# Autodesk Inventor assembly: Gimbal_ze_starym_rodem
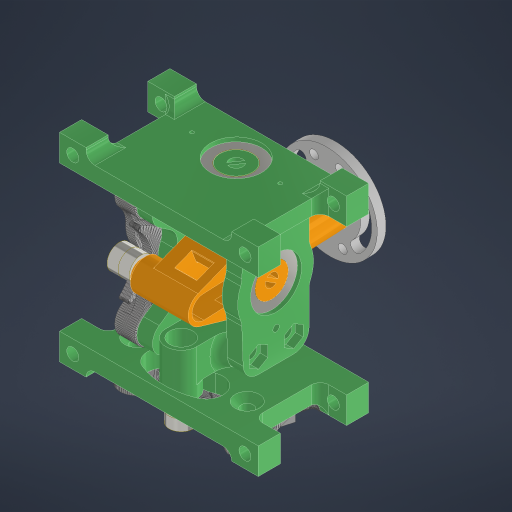
[picture p0: Inventor's stored thumbnail of the model, 512x512]
Saved by Autodesk Inventor 2023 (Build 270158000, 158)
## iProperties
Created: 2026-11-06
Part Number: Gimbal_ze_starym_rodem
Document SubType Name: Assembly
Designer: szykr
Author: szykr
## Documents named in this file (14)
- D:\Folder Instalacyjny\GitHub Pliki\HOTAS\Inventor\Gimbal\Gimbal_ze_starym_rodem.iam
- D:\Folder Instalacyjny\GitHub Pliki\HOTAS\Inventor\Gimbal\gimbal_cam.ipt
- D:\Folder Instalacyjny\GitHub Pliki\HOTAS\Inventor\Gimbal\gimbal_core_bearing_carrier.ipt
- D:\Folder Instalacyjny\GitHub Pliki\HOTAS\Inventor\Gimbal\gimbal_core_bearing_carrier_6802zz.ipt
- D:\Folder Instalacyjny\GitHub Pliki\HOTAS\Inventor\Gimbal\gimbal_core_non_pot_side.ipt
- D:\Folder Instalacyjny\GitHub Pliki\HOTAS\Inventor\Gimbal\gimbal_core_pot_side.ipt
- D:\Folder Instalacyjny\GitHub Pliki\HOTAS\Inventor\Gimbal\gimbal_frame.ipt
- D:\Folder Instalacyjny\GitHub Pliki\HOTAS\Inventor\Gimbal\gimbal_frame_6802zz.ipt
- D:\Folder Instalacyjny\GitHub Pliki\HOTAS\Inventor\Gimbal\gimbal_lever_arm.ipt
- D:\Folder Instalacyjny\GitHub Pliki\HOTAS\Inventor\gimbal2\Cam_modified.ipt
- D:\Folder Instalacyjny\GitHub Pliki\HOTAS\Inventor\Gimbal\lozyska\685ZZ_(618[slash]5).ipt
- D:\Folder Instalacyjny\GitHub Pliki\HOTAS\Inventor\Gimbal\lozyska\6802ZZ_61802.ipt
- D:\Folder Instalacyjny\GitHub Pliki\HOTAS\Inventor\Gimbal\Adapter.ipt
- D:\Folder Instalacyjny\GitHub Pliki\HOTAS\Inventor\Gimbal\Rod.iam
## Components (29 placed, 13 different names)
1. gimbal_cam:1 — Insert:11
2. gimbal_core_bearing_carrier:1 — Insert:2, Insert:3, Insert:4, Insert:5, Insert:8, Insert:35
3. gimbal_core_bearing_carrier_6802zz:1 — Insert:6, Insert:7, Insert:11, Insert:16, Insert:17, Insert:18, Angle:4
4. gimbal_core_non_pot_side:1 — Insert:2, Insert:3, Insert:7, Insert:9, Insert:23, Insert:31
5. gimbal_core_pot_side:1 — Insert:4, Insert:5, Insert:6, Insert:10, Insert:29
6. gimbal_frame:1 — Insert:10, Angle:2
7. gimbal_frame_6802zz:1 — Insert:9, Angle:1, Angle:2, Insert:14, Insert:15, Insert:19, Insert:20
8. gimbal_lever_arm:1 — Insert:8, Insert:27, Insert:30, Insert:32, Insert:34
9. gimbal_cam:2 — Insert:15
10. gimbal_cam:3 — Insert:14
11. gimbal_cam:4 — Insert:16
12. Cam_modified:1 — Insert:17, Insert:25
13. Cam_modified:2 — Insert:20, Insert:22
14. Cam_modified:3 — Insert:19, Insert:21
15. Cam_modified:4 — Insert:18, Insert:26
16. 685ZZ_(618[slash]5):1 — Insert:22
17. 685ZZ_(618[slash]5):2 — Insert:23, Insert:24
18. 685ZZ_(618[slash]5):3 — Insert:24
19. 685ZZ_(618[slash]5):4 — Insert:21
20. 685ZZ_(618[slash]5):5 — Insert:28
21. 685ZZ_(618[slash]5):6 — Insert:27, Insert:28
22. 685ZZ_(618[slash]5):7 — Insert:26
23. 685ZZ_(618[slash]5):8 — Insert:25
24. 6802ZZ_61802:1 — Insert:32
25. 6802ZZ_61802:2 — Insert:31
26. 6802ZZ_61802:3 — Insert:30
27. 6802ZZ_61802:4 — Insert:29
28. Adapter:2 — Insert:34, Angle:4
29. Rod:1 [sub-assembly] — Insert:35
## Relationships (34: Insert 31, Angle 3)
- Insert:2: gimbal_core_bearing_carrier:1 ↔ gimbal_core_non_pot_side:1
- Insert:3: gimbal_core_bearing_carrier:1 ↔ gimbal_core_non_pot_side:1
- Insert:4: gimbal_core_bearing_carrier:1 ↔ gimbal_core_pot_side:1
- Insert:5: gimbal_core_bearing_carrier:1 ↔ gimbal_core_pot_side:1
- Insert:6: gimbal_core_bearing_carrier_6802zz:1 ↔ gimbal_core_pot_side:1
- Insert:7: gimbal_core_bearing_carrier_6802zz:1 ↔ gimbal_core_non_pot_side:1
- Insert:8: gimbal_core_bearing_carrier:1 ↔ gimbal_lever_arm:1
- Insert:9: gimbal_core_non_pot_side:1 ↔ gimbal_frame_6802zz:1
- Angle:1 (180 deg): gimbal_frame_6802zz:1
- Insert:10: gimbal_core_pot_side:1 ↔ gimbal_frame:1
- Angle:2 (0 deg): gimbal_frame:1 ↔ gimbal_frame_6802zz:1
- Insert:11: gimbal_cam:1 ↔ gimbal_core_bearing_carrier_6802zz:1
- Insert:14: gimbal_frame_6802zz:1 ↔ gimbal_cam:3
- Insert:15: gimbal_frame_6802zz:1 ↔ gimbal_cam:2
- Insert:16: gimbal_core_bearing_carrier_6802zz:1 ↔ gimbal_cam:4
- Insert:17: gimbal_core_bearing_carrier_6802zz:1 ↔ Cam_modified:1
- Insert:18: gimbal_core_bearing_carrier_6802zz:1 ↔ Cam_modified:4
- Insert:19: gimbal_frame_6802zz:1 ↔ Cam_modified:3
- Insert:20: gimbal_frame_6802zz:1 ↔ Cam_modified:2
- Insert:21: Cam_modified:3 ↔ 685ZZ_(618[slash]5):4
- Insert:22: Cam_modified:2 ↔ 685ZZ_(618[slash]5):1
- Insert:23: gimbal_core_non_pot_side:1 ↔ 685ZZ_(618[slash]5):2
- Insert:24: 685ZZ_(618[slash]5):2 ↔ 685ZZ_(618[slash]5):3
- Insert:25: Cam_modified:1 ↔ 685ZZ_(618[slash]5):8
- Insert:26: Cam_modified:4 ↔ 685ZZ_(618[slash]5):7
- Insert:27: gimbal_lever_arm:1 ↔ 685ZZ_(618[slash]5):6
- Insert:28: 685ZZ_(618[slash]5):5 ↔ 685ZZ_(618[slash]5):6
- Insert:29: gimbal_core_pot_side:1 ↔ 6802ZZ_61802:4
- Insert:30: gimbal_lever_arm:1 ↔ 6802ZZ_61802:3
- Insert:31: gimbal_core_non_pot_side:1 ↔ 6802ZZ_61802:2
- Insert:32: gimbal_lever_arm:1 ↔ 6802ZZ_61802:1
- Insert:34: gimbal_lever_arm:1 ↔ Adapter:2
- Angle:4 (-90 deg): gimbal_core_bearing_carrier_6802zz:1 ↔ Adapter:2
- Insert:35: gimbal_core_bearing_carrier:1 ↔ Rod:1
